# Autodesk Inventor assembly: LiPo-Unit
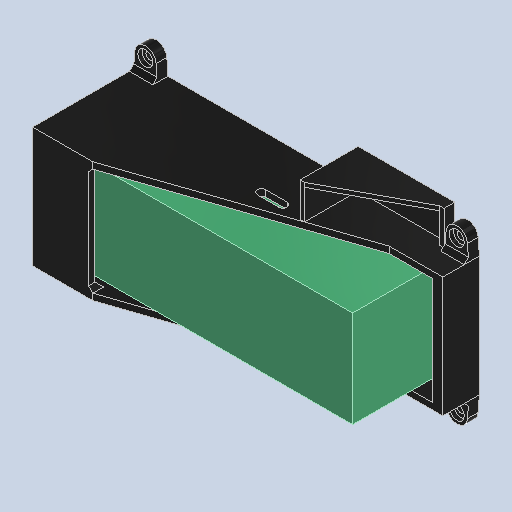
[picture p0: Inventor's stored thumbnail of the model, 512x512]
Saved by Autodesk Inventor 2025.3 (Build 293356030, 356C)
## iProperties
Created: 2025-08-02
Part Number: LiPo-Unit
Document SubType Name: Assembly
Designer: ibuki_ono
Author: ibuki_ono
## Documents named in this file (3)
- C:\Users\ibuki_ono\Documents\hobby\rogiken\catchrobo\CAD\Hardware_CAD\Inventor\circuit\LiPo-Unit.iam
- C:\Users\ibuki_ono\Documents\hobby\rogiken\catchrobo\CAD\Hardware_CAD\Inventor\circuit\3D_LiPo-case.ipt
- C:\Users\ibuki_ono\Documents\hobby\rogiken\catchrobo\CAD\Hardware_CAD\Inventor\circuit\LiPo6cell.ipt
## Components (2 placed, 2 different names)
1. 3D_LiPo-case:1 — メイト:1, メイト:2, メイト:3
2. LiPo6cell:1 — メイト:1, メイト:2, メイト:3
## Relationships (3: Mate 3)
- メイト:1 [Mate]: 3D_LiPo-case:1 ↔ LiPo6cell:1
- メイト:2 [Mate]: 3D_LiPo-case:1 ↔ LiPo6cell:1
- メイト:3 [Mate] (2.5 mm): 3D_LiPo-case:1 ↔ LiPo6cell:1
